# Autodesk Inventor assembly: LM8UU
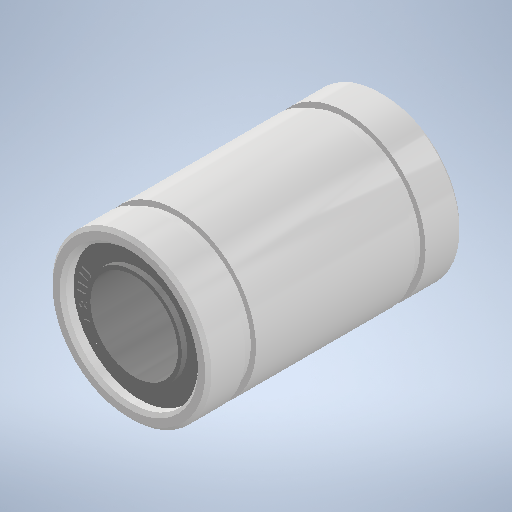
[picture p0: Inventor's stored thumbnail of the model, 512x512]
Saved by Autodesk Inventor 2025.1 (Build 291241000, 241)
## iProperties
Created: 2023-07-16
Part Number: LM8UU
Description: STEP AP214
Document SubType Name: Assembly
Designer: Ваня
Title: LM8UU.stp
Revision Number: NONE
Preprocessor: Spatial InterOp 3D
## Documents named in this file (3)
- C:\Users\Ваня\Desktop\SCARA_ETZ_2027\3D Модели\Для сборки\Подшипники\LM8UU.iam
- C:\Users\Ваня\Downloads\lm8uu-14.snapshot.2\LM8UU\LM8UU\LM8UU.ipt
- C:\Users\Ваня\Downloads\lm8uu-14.snapshot.2\LM8UU\LM8UU\in.ipt
## Components (2 placed, 2 different names)
1. LM8UU — Жесткий:1
2. in — Жесткий:1
## Relationships (1: WeldJoint 1)
- Жесткий:1 [WeldJoint]: LM8UU ↔ in
